# Autodesk Inventor assembly: Sensor unit
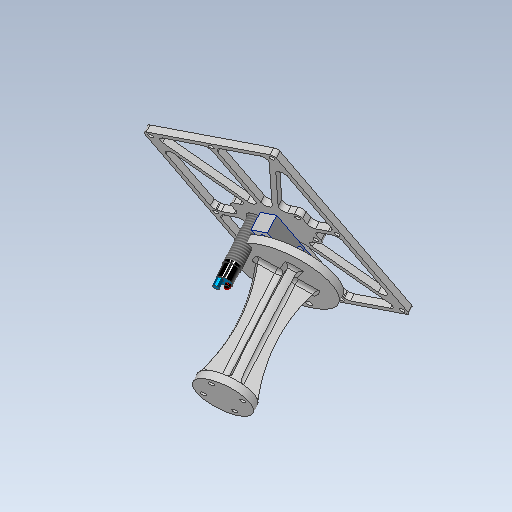
[picture p0: Inventor's stored thumbnail of the model, 512x512]
Saved by Autodesk Inventor 2026.2 (Build 302298010, 298A)
## iProperties
Created: 2026-03-18
Part Number: Sensor unit
Document SubType Name: Assembly
Designer: work
Author: work
## Documents named in this file (22)
- C:\Users\khw\Desktop\ARD_v1\ARD_hardware\ARD_Model_v1\Sensor unit.iam
- C:\Users\khw\Desktop\ARD_v1\ARD_hardware\ARD_Model_v1\Object\로드셀 센서.ipt
- C:\Users\khw\Desktop\ARD_v1\ARD_hardware\ARD_Model_v1\lj12.ipt
- C:\Users\khw\Desktop\ARD_v1\ARD_hardware\PL121248Drive_v1\R2-v2.ipt
- C:\Users\khw\Desktop\ARD_v1\ARD_hardware\ARD_Model_v1\KS B 1003 - M 4 x 10.ipt
- C:\Users\khw\Desktop\ARD_v1\ARD_hardware\ARD_Model_v1\Load cell support.ipt
- C:\Users\khw\Desktop\ARD_v1\ARD_hardware\ARD_Model_v1\2B_set\AIP\FEA\fdflh83ds.fins
- C:\Users\khw\Desktop\ARD_v1\ARD_hardware\ARD_Model_v1\2B_set\AIP\FEA\fdflh83ds.fsat
- C:\Users\khw\Desktop\ARD_v1\ARD_hardware\ARD_Model_v1\2B_set\AIP\FEA\fdflh83ds.ftes
- C:\Users\khw\Desktop\ARD_v1\ARD_hardware\ARD_Model_v1\2B_set\AIP\FEA\fdflh83ds.fwiz
- C:\Users\khw\Desktop\ARD_v1\ARD_hardware\ARD_Model_v1\2B_set_rali\AIP\FEA\fdjqx1t5s.fins
- C:\Users\khw\Desktop\ARD_v1\ARD_hardware\ARD_Model_v1\2B_set_rali\AIP\FEA\fdjqx1t5s.fsat
- C:\Users\khw\Desktop\ARD_v1\ARD_hardware\ARD_Model_v1\2B_set_rali\AIP\FEA\fdjqx1t5s.ftes
- C:\Users\khw\Desktop\ARD_v1\ARD_hardware\ARD_Model_v1\2B_set_rali\AIP\FEA\fdjqx1t5s.fwiz
- C:\Users\khw\Desktop\ARD_v1\ARD_hardware\ARD_Model_v1\2\AIP\FEA\fdyt8wk5c.fins
- C:\Users\khw\Desktop\ARD_v1\ARD_hardware\ARD_Model_v1\2\AIP\FEA\fdyt8wk5c.fsat
- C:\Users\khw\Desktop\ARD_v1\ARD_hardware\ARD_Model_v1\2\AIP\FEA\fdyt8wk5c.ftes
- C:\Users\khw\Desktop\ARD_v1\ARD_hardware\ARD_Model_v1\2\AIP\FEA\fdyt8wk5c.fwiz
- C:\Users\khw\Desktop\ARD_v1\ARD_hardware\ARD_Model_v1\Sensor unit\AIP\FEA\fewtachc0.fins
- C:\Users\khw\Desktop\ARD_v1\ARD_hardware\ARD_Model_v1\Sensor unit\AIP\FEA\fewtachc0.fsat
- C:\Users\khw\Desktop\ARD_v1\ARD_hardware\ARD_Model_v1\Sensor unit\AIP\FEA\fewtachc0.ftes
- C:\Users\khw\Desktop\ARD_v1\ARD_hardware\ARD_Model_v1\Sensor unit\AIP\FEA\fewtachc0.fwiz
## Components (6 placed, 5 different names)
1. lj12:1 — 회전:48
2. R2-v2:1 — 회전:48, 메이트:70, 메이트:71, 메이트:72, 회전:49, 회전:50
3. KS B 1003 - M 4 x 10:1 — 회전:49
4. KS B 1003 - M 4 x 10:2 — 회전:50
5. Load cell support:1 — 메이트:73, 메이트:74, 메이트:75
6. 로드셀 센서:1 — 메이트:70, 메이트:71, 메이트:72, 메이트:73, 메이트:74, 메이트:75
## Relationships (9: Mate 6, RevoluteJoint 3)
- 회전:48 [RevoluteJoint]: lj12:1 ↔ R2-v2:1
- 메이트:70 [Mate]: R2-v2:1 ↔ 로드셀 센서:1
- 메이트:71 [Mate]: R2-v2:1 ↔ 로드셀 센서:1
- 메이트:72 [Mate]: R2-v2:1 ↔ 로드셀 센서:1
- 회전:49 [RevoluteJoint]: R2-v2:1 ↔ KS B 1003 - M 4 x 10:1
- 회전:50 [RevoluteJoint]: R2-v2:1 ↔ KS B 1003 - M 4 x 10:2
- 메이트:73 [Mate]: Load cell support:1 ↔ 로드셀 센서:1
- 메이트:74 [Mate]: Load cell support:1 ↔ 로드셀 센서:1
- 메이트:75 [Mate]: Load cell support:1 ↔ 로드셀 센서:1
## Named parameters: sa_0 = 10000
note: some values were not read from the file. Shown as the stored number, unit unknown: "sa_0".
